# Autodesk Inventor assembly: Final QArm Gripper
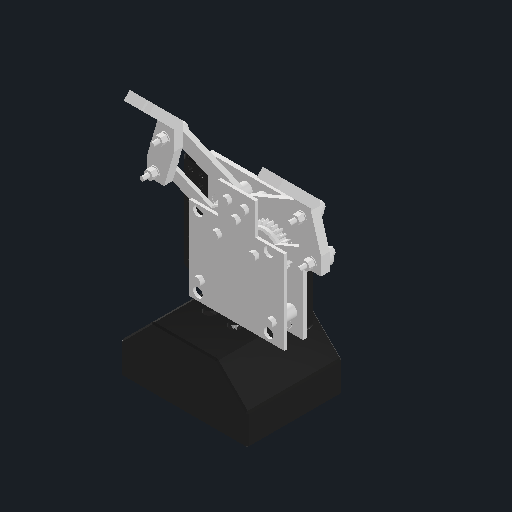
[picture p0: Inventor's stored thumbnail of the model, 512x512]
Saved by Autodesk Inventor 2027.1 (Build 311270010, 270A)
## iProperties
Created: 2026-11-03
Part Number: Final QArm Gripper
Document SubType Name: Assembly
Designer: anshi
Author: anshi
## Documents named in this file (25)
- C:\Users\anshi\Desktop\school\1P13\Design Studio\proj1 cad1\finalparts\Final QArm Gripper.iam
- C:\Users\anshi\Desktop\school\1P13\Design Studio\proj1 cad1\finalparts\P1-01_Lower_Mounting_Frame.ipt
- C:\Users\anshi\Desktop\school\1P13\Design Studio\proj1 cad1\finalparts\P4-04 Upper axle-support plate.ipt
- C:\Users\anshi\Desktop\school\1P13\Design Studio\proj1 cad1\finalparts\P1-02 Design Study Structural Pillar.ipt
- P1-02 Design Studio Structural Pillar.ipt
- C:\Users\anshi\Desktop\school\1P13\Design Studio\proj1 cad1\finalparts\UpperPivotSpacer.ipt
- C:\Users\anshi\Desktop\school\1P13\Design Studio\proj1 cad1\finalparts\Hardware\M3x20 socket screw.ipt
- C:\Users\anshi\Desktop\school\1P13\Design Studio\proj1 cad1\finalparts\Hardware\M3 hex nut.ipt
- C:\Users\anshi\Desktop\school\1P13\Design Studio\proj1 cad1\finalparts\P2-01 Input pinion 18 teeth.ipt
- C:\Users\anshi\Desktop\school\1P13\Design Studio\proj1 cad1\finalparts\Update 1.2 Uppercrankline and Left Driven Gears.ipt
- C:\Users\anshi\Desktop\school\1P13\Design Studio\proj1 cad1\finalparts\LowerFollowerLink.ipt
- C:\Users\anshi\Desktop\school\1P13\Design Studio\proj1 cad1\finalparts\LowerPivotSpacer.ipt
- C:\Users\anshi\Desktop\school\1P13\Design Studio\proj1 cad1\finalparts\Update 1.2 Left Finger and Pad Carrier.ipt
- C:\Users\anshi\Desktop\school\1P13\Design Studio\proj1 cad1\finalparts\P4-05 Foam contact pad.ipt
- C:\Users\anshi\Desktop\school\1P13\Design Studio\proj1 cad1\finalparts\Hardware\M3 washer 0.5mm.ipt
- C:\Users\anshi\Desktop\school\1P13\Design Studio\proj1 cad1\finalparts\Hardware\M3 nyloc nut.ipt
- C:\Users\anshi\Desktop\school\1P13\Design Studio\proj1 cad1\finalparts\Update 1.2 Uppercrankline and Right Driven Gears.ipt
- C:\Users\anshi\Desktop\school\1P13\Design Studio\proj1 cad1\finalparts\Update 1.2 Right Finger and Pad Carrier.ipt
- C:\Users\anshi\Desktop\school\1P13\Design Studio\proj1 cad1\finalparts\ReferencePlatform\End Effector Platform - rotating shaft reference.iam
- C:\Users\anshi\Desktop\school\1P13\Design Studio\proj1 cad1\finalparts\Hardware\M3x10 countersunk screw.ipt
- C:\Users\anshi\Desktop\school\1P13\Design Studio\proj1 cad1\finalparts\Hardware\N20 rotating output shaft reference.ipt
- C:\Users\anshi\Desktop\school\1P13\Design Studio\proj1 cad1\finalparts\Hardware\M3x4 grub screw.ipt
- C:\Users\anshi\Desktop\school\1P13\Design Studio\proj1 cad1\finalparts\Hardware\Pivot sleeve 4OD 3.2ID x10.5.ipt
- C:\Users\anshi\Desktop\school\1P13\Design Studio\proj1 cad1\finalparts\Hardware\Pivot sleeve 4OD 3.2ID x11.ipt
- C:\Users\anshi\Desktop\school\1P13\Design Studio\proj1 cad1\finalparts\Hardware\M3x16 socket screw.ipt
## Components (73 placed, 73 different names)
1. Lower mounting frame — Upper axle-support plate - datum 1, Upper axle-support plate - datum 2, Upper axle-support plate - datum 3, Structural pillar 1 - datum 1, Structural pillar 1 - datum 2, Structural pillar 1 - datum 3, Structural pillar 2 - datum 1, Structural pillar 2 - datum 2, Structural pillar 2 - datum 3, Structural pillar 3 - datum 1, Structural pillar 3 - datum 2, Structural pillar 3 - datum 3, Upper pivot spacer 1 - datum 1, Upper pivot spacer 1 - datum 2, Upper pivot spacer 1 - datum 3, Fixed pivot metal sleeve 1 - datum 1, Fixed pivot metal sleeve 1 - datum 2, Fixed pivot metal sleeve 1 - datum 3, Upper pivot spacer 2 - datum 1, Upper pivot spacer 2 - datum 2, Upper pivot spacer 2 - datum 3, Fixed pivot metal sleeve 2 - datum 1, Fixed pivot metal sleeve 2 - datum 2, Fixed pivot metal sleeve 2 - datum 3, Upper pivot spacer 3 - datum 1, Upper pivot spacer 3 - datum 2, Upper pivot spacer 3 - datum 3, Fixed pivot metal sleeve 3 - datum 1, Fixed pivot metal sleeve 3 - datum 2, Fixed pivot metal sleeve 3 - datum 3, Upper pivot spacer 4 - datum 1, Upper pivot spacer 4 - datum 2, Upper pivot spacer 4 - datum 3, Fixed pivot metal sleeve 4 - datum 1, Fixed pivot metal sleeve 4 - datum 2, Fixed pivot metal sleeve 4 - datum 3, M3 frame bolt 1 - datum 1, M3 frame bolt 1 - datum 2, M3 frame bolt 1 - datum 3, M3 frame bolt 2 - datum 1, M3 frame bolt 2 - datum 2, M3 frame bolt 2 - datum 3, M3 frame bolt 3 - datum 1, M3 frame bolt 3 - datum 2, M3 frame bolt 3 - datum 3, M3 frame bolt 4 - datum 1, M3 frame bolt 4 - datum 2, M3 frame bolt 4 - datum 3, M3 captive frame nut 4 - datum 1, M3 captive frame nut 4 - datum 2, M3 captive frame nut 4 - datum 3, M3 frame bolt 5 - datum 1, M3 frame bolt 5 - datum 2, M3 frame bolt 5 - datum 3, M3 captive frame nut 5 - datum 1, M3 captive frame nut 5 - datum 2, M3 captive frame nut 5 - datum 3, M3 frame bolt 6 - datum 1, M3 frame bolt 6 - datum 2, M3 frame bolt 6 - datum 3, M3 captive frame nut 6 - datum 1, M3 captive frame nut 6 - datum 2, M3 captive frame nut 6 - datum 3, M3 frame bolt 7 - datum 1, M3 frame bolt 7 - datum 2, M3 frame bolt 7 - datum 3, M3 captive frame nut 7 - datum 1, M3 captive frame nut 7 - datum 2, M3 captive frame nut 7 - datum 3, Left lower pivot spacer - datum 1, Left lower pivot spacer - datum 2, Left lower pivot spacer - datum 3, Right lower pivot spacer - datum 1, Right lower pivot spacer - datum 2, Right lower pivot spacer - datum 3, QArm supplied end effector platform - datum 1, QArm supplied end effector platform - datum 2, QArm supplied end effector platform - datum 3, Platform M3 mounting screw 1 - datum 1, Platform M3 mounting screw 1 - datum 2, Platform M3 mounting screw 1 - datum 3, Platform M3 washer 1 - datum 1, Platform M3 washer 1 - datum 2, Platform M3 washer 1 - datum 3, Platform M3 nut 1 - datum 1, Platform M3 nut 1 - datum 2, Platform M3 nut 1 - datum 3, Platform M3 mounting screw 2 - datum 1, Platform M3 mounting screw 2 - datum 2, Platform M3 mounting screw 2 - datum 3, Platform M3 washer 2 - datum 1, Platform M3 washer 2 - datum 2, Platform M3 washer 2 - datum 3, Platform M3 nut 2 - datum 1, Platform M3 nut 2 - datum 2, Platform M3 nut 2 - datum 3, Platform M3 mounting screw 3 - datum 1, Platform M3 mounting screw 3 - datum 2, Platform M3 mounting screw 3 - datum 3, Platform M3 washer 3 - datum 1, Platform M3 washer 3 - datum 2, Platform M3 washer 3 - datum 3, Platform M3 nut 3 - datum 1, Platform M3 nut 3 - datum 2, Platform M3 nut 3 - datum 3, Platform M3 mounting screw 4 - datum 1, Platform M3 mounting screw 4 - datum 2, Platform M3 mounting screw 4 - datum 3, Platform M3 washer 4 - datum 1, Platform M3 washer 4 - datum 2, Platform M3 washer 4 - datum 3, Platform M3 nut 4 - datum 1, Platform M3 nut 4 - datum 2, Platform M3 nut 4 - datum 3, Input pinion height, Input shaft axis, Left gear face height, Left gear pivot, Left follower height, Left follower pivot, Left finger height, Right gear face height, Right gear pivot, Right follower height, Right follower pivot, Right finger height, Jaw opening drive, M3 captive frame nut 1 axis, M3 captive frame nut 1 height, M3 captive frame nut 1 pocket orientation, M3 captive frame nut 2 axis, M3 captive frame nut 2 height, M3 captive frame nut 2 pocket orientation, M3 captive frame nut 3 axis, M3 captive frame nut 3 height, M3 captive frame nut 3 pocket orientation
2. Upper axle-support plate — Upper axle-support plate - datum 1, Upper axle-support plate - datum 2, Upper axle-support plate - datum 3
3. Structural pillar 1 — Structural pillar 1 - datum 1, Structural pillar 1 - datum 2, Structural pillar 1 - datum 3
4. Structural pillar 2 — Structural pillar 2 - datum 1, Structural pillar 2 - datum 2, Structural pillar 2 - datum 3
5. Structural pillar 3 — Structural pillar 3 - datum 1, Structural pillar 3 - datum 2, Structural pillar 3 - datum 3
6. Upper pivot spacer 1 — Upper pivot spacer 1 - datum 1, Upper pivot spacer 1 - datum 2, Upper pivot spacer 1 - datum 3
7. Fixed pivot metal sleeve 1 — Fixed pivot metal sleeve 1 - datum 1, Fixed pivot metal sleeve 1 - datum 2, Fixed pivot metal sleeve 1 - datum 3
8. Upper pivot spacer 2 — Upper pivot spacer 2 - datum 1, Upper pivot spacer 2 - datum 2, Upper pivot spacer 2 - datum 3
9. Fixed pivot metal sleeve 2 — Fixed pivot metal sleeve 2 - datum 1, Fixed pivot metal sleeve 2 - datum 2, Fixed pivot metal sleeve 2 - datum 3
10. Upper pivot spacer 3 — Upper pivot spacer 3 - datum 1, Upper pivot spacer 3 - datum 2, Upper pivot spacer 3 - datum 3
11. Fixed pivot metal sleeve 3 — Fixed pivot metal sleeve 3 - datum 1, Fixed pivot metal sleeve 3 - datum 2, Fixed pivot metal sleeve 3 - datum 3
12. Upper pivot spacer 4 — Upper pivot spacer 4 - datum 1, Upper pivot spacer 4 - datum 2, Upper pivot spacer 4 - datum 3
13. Fixed pivot metal sleeve 4 — Fixed pivot metal sleeve 4 - datum 1, Fixed pivot metal sleeve 4 - datum 2, Fixed pivot metal sleeve 4 - datum 3
14. M3 frame bolt 1 — M3 frame bolt 1 - datum 1, M3 frame bolt 1 - datum 2, M3 frame bolt 1 - datum 3
15. M3 captive frame nut 1 — M3 captive frame nut 1 axis, M3 captive frame nut 1 height, M3 captive frame nut 1 pocket orientation
16. M3 frame bolt 2 — M3 frame bolt 2 - datum 1, M3 frame bolt 2 - datum 2, M3 frame bolt 2 - datum 3
17. M3 captive frame nut 2 — M3 captive frame nut 2 axis, M3 captive frame nut 2 height, M3 captive frame nut 2 pocket orientation
18. M3 frame bolt 3 — M3 frame bolt 3 - datum 1, M3 frame bolt 3 - datum 2, M3 frame bolt 3 - datum 3
19. M3 captive frame nut 3 — M3 captive frame nut 3 axis, M3 captive frame nut 3 height, M3 captive frame nut 3 pocket orientation
20. M3 frame bolt 4 — M3 frame bolt 4 - datum 1, M3 frame bolt 4 - datum 2, M3 frame bolt 4 - datum 3
21. M3 captive frame nut 4 — M3 captive frame nut 4 - datum 1, M3 captive frame nut 4 - datum 2, M3 captive frame nut 4 - datum 3
22. M3 frame bolt 5 — M3 frame bolt 5 - datum 1, M3 frame bolt 5 - datum 2, M3 frame bolt 5 - datum 3
23. M3 captive frame nut 5 — M3 captive frame nut 5 - datum 1, M3 captive frame nut 5 - datum 2, M3 captive frame nut 5 - datum 3
24. M3 frame bolt 6 — M3 frame bolt 6 - datum 1, M3 frame bolt 6 - datum 2, M3 frame bolt 6 - datum 3
25. M3 captive frame nut 6 — M3 captive frame nut 6 - datum 1, M3 captive frame nut 6 - datum 2, M3 captive frame nut 6 - datum 3
26. M3 frame bolt 7 — M3 frame bolt 7 - datum 1, M3 frame bolt 7 - datum 2, M3 frame bolt 7 - datum 3
27. M3 captive frame nut 7 — M3 captive frame nut 7 - datum 1, M3 captive frame nut 7 - datum 2, M3 captive frame nut 7 - datum 3
28. Motor input pinion 18T — Input pinion height, Input shaft axis, 26T to 18T external gear mesh, Rotating motor output shaft - datum 1, Rotating motor output shaft - datum 2, Rotating motor output shaft - datum 3, M3 motor shaft set screw - datum 1, M3 motor shaft set screw - datum 2, M3 motor shaft set screw - datum 3
29. Left driven gear 26T — Left gear face height, Left gear pivot, Left finger upper pivot, 26T to 26T external gear mesh, 26T to 18T external gear mesh, Jaw opening drive
30. Left lower follower — Left follower height, Left follower pivot, Left finger lower pivot
31. Left lower pivot spacer — Left lower pivot spacer - datum 1, Left lower pivot spacer - datum 2, Left lower pivot spacer - datum 3
32. Left finger — Left finger height, Left finger upper pivot, Left finger lower pivot, Left finger pivot 1 metal sleeve - datum 1, Left finger pivot 1 metal sleeve - datum 2, Left finger pivot 1 metal sleeve - datum 3, Left finger pivot 1 M3 bolt - datum 1, Left finger pivot 1 M3 bolt - datum 2, Left finger pivot 1 M3 bolt - datum 3, Left finger pivot 1 lower washer - datum 1, Left finger pivot 1 lower washer - datum 2, Left finger pivot 1 lower washer - datum 3, Left finger pivot 1 upper washer - datum 1, Left finger pivot 1 upper washer - datum 2, Left finger pivot 1 upper washer - datum 3, Left finger pivot 1 M3 locking nut - datum 1, Left finger pivot 1 M3 locking nut - datum 2, Left finger pivot 1 M3 locking nut - datum 3, Left finger pivot 2 metal sleeve - datum 1, Left finger pivot 2 metal sleeve - datum 2, Left finger pivot 2 metal sleeve - datum 3, Left finger pivot 2 M3 bolt - datum 1, Left finger pivot 2 M3 bolt - datum 2, Left finger pivot 2 M3 bolt - datum 3, Left finger pivot 2 lower washer - datum 1, Left finger pivot 2 lower washer - datum 2, Left finger pivot 2 lower washer - datum 3, Left finger pivot 2 upper washer - datum 1, Left finger pivot 2 upper washer - datum 2, Left finger pivot 2 upper washer - datum 3, Left finger pivot 2 M3 locking nut - datum 1, Left finger pivot 2 M3 locking nut - datum 2, Left finger pivot 2 M3 locking nut - datum 3, Left foam contact pad - datum 1, Left foam contact pad - datum 2, Left foam contact pad - datum 3
33. Left foam contact pad — Left foam contact pad - datum 1, Left foam contact pad - datum 2, Left foam contact pad - datum 3
34. Left finger pivot 1 metal sleeve — Left finger pivot 1 metal sleeve - datum 1, Left finger pivot 1 metal sleeve - datum 2, Left finger pivot 1 metal sleeve - datum 3
35. Left finger pivot 1 M3 bolt — Left finger pivot 1 M3 bolt - datum 1, Left finger pivot 1 M3 bolt - datum 2, Left finger pivot 1 M3 bolt - datum 3
36. Left finger pivot 1 lower washer — Left finger pivot 1 lower washer - datum 1, Left finger pivot 1 lower washer - datum 2, Left finger pivot 1 lower washer - datum 3
37. Left finger pivot 1 upper washer — Left finger pivot 1 upper washer - datum 1, Left finger pivot 1 upper washer - datum 2, Left finger pivot 1 upper washer - datum 3
38. Left finger pivot 1 M3 locking nut — Left finger pivot 1 M3 locking nut - datum 1, Left finger pivot 1 M3 locking nut - datum 2, Left finger pivot 1 M3 locking nut - datum 3
39. Left finger pivot 2 metal sleeve — Left finger pivot 2 metal sleeve - datum 1, Left finger pivot 2 metal sleeve - datum 2, Left finger pivot 2 metal sleeve - datum 3
40. Left finger pivot 2 M3 bolt — Left finger pivot 2 M3 bolt - datum 1, Left finger pivot 2 M3 bolt - datum 2, Left finger pivot 2 M3 bolt - datum 3
41. Left finger pivot 2 lower washer — Left finger pivot 2 lower washer - datum 1, Left finger pivot 2 lower washer - datum 2, Left finger pivot 2 lower washer - datum 3
42. Left finger pivot 2 upper washer — Left finger pivot 2 upper washer - datum 1, Left finger pivot 2 upper washer - datum 2, Left finger pivot 2 upper washer - datum 3
43. Left finger pivot 2 M3 locking nut — Left finger pivot 2 M3 locking nut - datum 1, Left finger pivot 2 M3 locking nut - datum 2, Left finger pivot 2 M3 locking nut - datum 3
44. Right driven gear 26T — Right gear face height, Right gear pivot, Right finger upper pivot, 26T to 26T external gear mesh
45. Right lower follower — Right follower height, Right follower pivot, Right finger lower pivot
46. Right lower pivot spacer — Right lower pivot spacer - datum 1, Right lower pivot spacer - datum 2, Right lower pivot spacer - datum 3
47. Right finger — Right finger height, Right finger upper pivot, Right finger lower pivot, Right finger pivot 1 metal sleeve - datum 1, Right finger pivot 1 metal sleeve - datum 2, Right finger pivot 1 metal sleeve - datum 3, Right finger pivot 1 M3 bolt - datum 1, Right finger pivot 1 M3 bolt - datum 2, Right finger pivot 1 M3 bolt - datum 3, Right finger pivot 1 lower washer - datum 1, Right finger pivot 1 lower washer - datum 2, Right finger pivot 1 lower washer - datum 3, Right finger pivot 1 upper washer - datum 1, Right finger pivot 1 upper washer - datum 2, Right finger pivot 1 upper washer - datum 3, Right finger pivot 1 M3 locking nut - datum 1, Right finger pivot 1 M3 locking nut - datum 2, Right finger pivot 1 M3 locking nut - datum 3, Right finger pivot 2 metal sleeve - datum 1, Right finger pivot 2 metal sleeve - datum 2, Right finger pivot 2 metal sleeve - datum 3, Right finger pivot 2 M3 bolt - datum 1, Right finger pivot 2 M3 bolt - datum 2, Right finger pivot 2 M3 bolt - datum 3, Right finger pivot 2 lower washer - datum 1, Right finger pivot 2 lower washer - datum 2, Right finger pivot 2 lower washer - datum 3, Right finger pivot 2 upper washer - datum 1, Right finger pivot 2 upper washer - datum 2, Right finger pivot 2 upper washer - datum 3, Right finger pivot 2 M3 locking nut - datum 1, Right finger pivot 2 M3 locking nut - datum 2, Right finger pivot 2 M3 locking nut - datum 3, Right foam contact pad - datum 1, Right foam contact pad - datum 2, Right foam contact pad - datum 3
48. Right foam contact pad — Right foam contact pad - datum 1, Right foam contact pad - datum 2, Right foam contact pad - datum 3
49. Right finger pivot 1 metal sleeve — Right finger pivot 1 metal sleeve - datum 1, Right finger pivot 1 metal sleeve - datum 2, Right finger pivot 1 metal sleeve - datum 3
50. Right finger pivot 1 M3 bolt — Right finger pivot 1 M3 bolt - datum 1, Right finger pivot 1 M3 bolt - datum 2, Right finger pivot 1 M3 bolt - datum 3
51. Right finger pivot 1 lower washer — Right finger pivot 1 lower washer - datum 1, Right finger pivot 1 lower washer - datum 2, Right finger pivot 1 lower washer - datum 3
52. Right finger pivot 1 upper washer — Right finger pivot 1 upper washer - datum 1, Right finger pivot 1 upper washer - datum 2, Right finger pivot 1 upper washer - datum 3
53. Right finger pivot 1 M3 locking nut — Right finger pivot 1 M3 locking nut - datum 1, Right finger pivot 1 M3 locking nut - datum 2, Right finger pivot 1 M3 locking nut - datum 3
54. Right finger pivot 2 metal sleeve — Right finger pivot 2 metal sleeve - datum 1, Right finger pivot 2 metal sleeve - datum 2, Right finger pivot 2 metal sleeve - datum 3
55. Right finger pivot 2 M3 bolt — Right finger pivot 2 M3 bolt - datum 1, Right finger pivot 2 M3 bolt - datum 2, Right finger pivot 2 M3 bolt - datum 3
56. Right finger pivot 2 lower washer — Right finger pivot 2 lower washer - datum 1, Right finger pivot 2 lower washer - datum 2, Right finger pivot 2 lower washer - datum 3
57. Right finger pivot 2 upper washer — Right finger pivot 2 upper washer - datum 1, Right finger pivot 2 upper washer - datum 2, Right finger pivot 2 upper washer - datum 3
58. Right finger pivot 2 M3 locking nut — Right finger pivot 2 M3 locking nut - datum 1, Right finger pivot 2 M3 locking nut - datum 2, Right finger pivot 2 M3 locking nut - datum 3
59. QArm supplied end effector platform [sub-assembly] — QArm supplied end effector platform - datum 1, QArm supplied end effector platform - datum 2, QArm supplied end effector platform - datum 3
60. Platform M3 mounting screw 1 — Platform M3 mounting screw 1 - datum 1, Platform M3 mounting screw 1 - datum 2, Platform M3 mounting screw 1 - datum 3
61. Platform M3 washer 1 — Platform M3 washer 1 - datum 1, Platform M3 washer 1 - datum 2, Platform M3 washer 1 - datum 3
62. Platform M3 nut 1 — Platform M3 nut 1 - datum 1, Platform M3 nut 1 - datum 2, Platform M3 nut 1 - datum 3
63. Platform M3 mounting screw 2 — Platform M3 mounting screw 2 - datum 1, Platform M3 mounting screw 2 - datum 2, Platform M3 mounting screw 2 - datum 3
64. Platform M3 washer 2 — Platform M3 washer 2 - datum 1, Platform M3 washer 2 - datum 2, Platform M3 washer 2 - datum 3
65. Platform M3 nut 2 — Platform M3 nut 2 - datum 1, Platform M3 nut 2 - datum 2, Platform M3 nut 2 - datum 3
66. Platform M3 mounting screw 3 — Platform M3 mounting screw 3 - datum 1, Platform M3 mounting screw 3 - datum 2, Platform M3 mounting screw 3 - datum 3
67. Platform M3 washer 3 — Platform M3 washer 3 - datum 1, Platform M3 washer 3 - datum 2, Platform M3 washer 3 - datum 3
68. Platform M3 nut 3 — Platform M3 nut 3 - datum 1, Platform M3 nut 3 - datum 2, Platform M3 nut 3 - datum 3
69. Platform M3 mounting screw 4 — Platform M3 mounting screw 4 - datum 1, Platform M3 mounting screw 4 - datum 2, Platform M3 mounting screw 4 - datum 3
70. Platform M3 washer 4 — Platform M3 washer 4 - datum 1, Platform M3 washer 4 - datum 2, Platform M3 washer 4 - datum 3
71. Platform M3 nut 4 — Platform M3 nut 4 - datum 1, Platform M3 nut 4 - datum 2, Platform M3 nut 4 - datum 3
72. Rotating motor output shaft — Rotating motor output shaft - datum 1, Rotating motor output shaft - datum 2, Rotating motor output shaft - datum 3
73. M3 motor shaft set screw — M3 motor shaft set screw - datum 1, M3 motor shaft set screw - datum 2, M3 motor shaft set screw - datum 3
## Relationships (214: Flush 171, Mate 37, Angle 4, RelateRotation 2)
- Upper axle-support plate - datum 1 [Flush]: Lower mounting frame ↔ Upper axle-support plate
- Upper axle-support plate - datum 2 [Flush]: Lower mounting frame ↔ Upper axle-support plate
- Upper axle-support plate - datum 3 [Flush] (14 mm): Lower mounting frame ↔ Upper axle-support plate
- Structural pillar 1 - datum 1 [Flush] (-12 mm): Lower mounting frame ↔ Structural pillar 1
- Structural pillar 1 - datum 2 [Flush] (3 mm): Lower mounting frame ↔ Structural pillar 1
- Structural pillar 1 - datum 3 [Mate] (-12 mm): Lower mounting frame ↔ Structural pillar 1
- Structural pillar 2 - datum 1 [Flush] (38 mm): Lower mounting frame ↔ Structural pillar 2
- Structural pillar 2 - datum 2 [Flush] (3 mm): Lower mounting frame ↔ Structural pillar 2
- Structural pillar 2 - datum 3 [Mate] (-12 mm): Lower mounting frame ↔ Structural pillar 2
- Structural pillar 3 - datum 1 [Flush] (13 mm): Lower mounting frame ↔ Structural pillar 3
- Structural pillar 3 - datum 2 [Flush] (3 mm): Lower mounting frame ↔ Structural pillar 3
- Structural pillar 3 - datum 3 [Mate] (37 mm): Lower mounting frame ↔ Structural pillar 3
- Upper pivot spacer 1 - datum 1 [Flush]: Lower mounting frame ↔ Upper pivot spacer 1
- Upper pivot spacer 1 - datum 2 [Flush] (11.5 mm): Lower mounting frame ↔ Upper pivot spacer 1
- Upper pivot spacer 1 - datum 3 [Mate] (22 mm): Lower mounting frame ↔ Upper pivot spacer 1
- Fixed pivot metal sleeve 1 - datum 1 [Flush]: Lower mounting frame ↔ Fixed pivot metal sleeve 1
- Fixed pivot metal sleeve 1 - datum 2 [Flush] (22 mm): Lower mounting frame ↔ Fixed pivot metal sleeve 1
- Fixed pivot metal sleeve 1 - datum 3 [Flush] (3 mm): Lower mounting frame ↔ Fixed pivot metal sleeve 1
- Upper pivot spacer 2 - datum 1 [Flush] (26 mm): Lower mounting frame ↔ Upper pivot spacer 2
- Upper pivot spacer 2 - datum 2 [Flush] (11.5 mm): Lower mounting frame ↔ Upper pivot spacer 2
- Upper pivot spacer 2 - datum 3 [Mate] (22 mm): Lower mounting frame ↔ Upper pivot spacer 2
- Fixed pivot metal sleeve 2 - datum 1 [Flush] (26 mm): Lower mounting frame ↔ Fixed pivot metal sleeve 2
- Fixed pivot metal sleeve 2 - datum 2 [Flush] (22 mm): Lower mounting frame ↔ Fixed pivot metal sleeve 2
- Fixed pivot metal sleeve 2 - datum 3 [Flush] (3 mm): Lower mounting frame ↔ Fixed pivot metal sleeve 2
- Upper pivot spacer 3 - datum 1 [Flush] (7 mm): Lower mounting frame ↔ Upper pivot spacer 3
- Upper pivot spacer 3 - datum 2 [Flush] (11.5 mm): Lower mounting frame ↔ Upper pivot spacer 3
- Upper pivot spacer 3 - datum 3 [Mate] (46 mm): Lower mounting frame ↔ Upper pivot spacer 3
- Fixed pivot metal sleeve 3 - datum 1 [Flush] (7 mm): Lower mounting frame ↔ Fixed pivot metal sleeve 3
- Fixed pivot metal sleeve 3 - datum 2 [Flush] (46 mm): Lower mounting frame ↔ Fixed pivot metal sleeve 3
- Fixed pivot metal sleeve 3 - datum 3 [Flush] (3 mm): Lower mounting frame ↔ Fixed pivot metal sleeve 3
- Upper pivot spacer 4 - datum 1 [Flush] (19 mm): Lower mounting frame ↔ Upper pivot spacer 4
- Upper pivot spacer 4 - datum 2 [Flush] (11.5 mm): Lower mounting frame ↔ Upper pivot spacer 4
- Upper pivot spacer 4 - datum 3 [Mate] (46 mm): Lower mounting frame ↔ Upper pivot spacer 4
- Fixed pivot metal sleeve 4 - datum 1 [Flush] (19 mm): Lower mounting frame ↔ Fixed pivot metal sleeve 4
- Fixed pivot metal sleeve 4 - datum 2 [Flush] (46 mm): Lower mounting frame ↔ Fixed pivot metal sleeve 4
- Fixed pivot metal sleeve 4 - datum 3 [Flush] (3 mm): Lower mounting frame ↔ Fixed pivot metal sleeve 4
- M3 frame bolt 1 - datum 1 [Flush] (-12 mm): Lower mounting frame ↔ M3 frame bolt 1
- M3 frame bolt 1 - datum 2 [Mate] (-12 mm): Lower mounting frame ↔ M3 frame bolt 1
- M3 frame bolt 1 - datum 3 [Mate] (16 mm): Lower mounting frame ↔ M3 frame bolt 1
- M3 frame bolt 2 - datum 1 [Flush] (38 mm): Lower mounting frame ↔ M3 frame bolt 2
- M3 frame bolt 2 - datum 2 [Mate] (-12 mm): Lower mounting frame ↔ M3 frame bolt 2
- M3 frame bolt 2 - datum 3 [Mate] (16 mm): Lower mounting frame ↔ M3 frame bolt 2
- M3 frame bolt 3 - datum 1 [Flush] (13 mm): Lower mounting frame ↔ M3 frame bolt 3
- M3 frame bolt 3 - datum 2 [Mate] (37 mm): Lower mounting frame ↔ M3 frame bolt 3
- M3 frame bolt 3 - datum 3 [Mate] (16 mm): Lower mounting frame ↔ M3 frame bolt 3
- M3 frame bolt 4 - datum 1 [Flush]: Lower mounting frame ↔ M3 frame bolt 4
- M3 frame bolt 4 - datum 2 [Mate] (22 mm): Lower mounting frame ↔ M3 frame bolt 4
- M3 frame bolt 4 - datum 3 [Mate] (16 mm): Lower mounting frame ↔ M3 frame bolt 4
- M3 captive frame nut 4 - datum 1 [Flush]: Lower mounting frame ↔ M3 captive frame nut 4
- M3 captive frame nut 4 - datum 2 [Flush] (22 mm): Lower mounting frame ↔ M3 captive frame nut 4
- M3 captive frame nut 4 - datum 3 [Flush]: Lower mounting frame ↔ M3 captive frame nut 4
- M3 frame bolt 5 - datum 1 [Flush] (26 mm): Lower mounting frame ↔ M3 frame bolt 5
- M3 frame bolt 5 - datum 2 [Mate] (22 mm): Lower mounting frame ↔ M3 frame bolt 5
- M3 frame bolt 5 - datum 3 [Mate] (16 mm): Lower mounting frame ↔ M3 frame bolt 5
- M3 captive frame nut 5 - datum 1 [Flush] (26 mm): Lower mounting frame ↔ M3 captive frame nut 5
- M3 captive frame nut 5 - datum 2 [Flush] (22 mm): Lower mounting frame ↔ M3 captive frame nut 5
- M3 captive frame nut 5 - datum 3 [Flush]: Lower mounting frame ↔ M3 captive frame nut 5
- M3 frame bolt 6 - datum 1 [Flush] (7 mm): Lower mounting frame ↔ M3 frame bolt 6
- M3 frame bolt 6 - datum 2 [Mate] (46 mm): Lower mounting frame ↔ M3 frame bolt 6
- M3 frame bolt 6 - datum 3 [Mate] (16 mm): Lower mounting frame ↔ M3 frame bolt 6
- M3 captive frame nut 6 - datum 1 [Flush] (7 mm): Lower mounting frame ↔ M3 captive frame nut 6
- M3 captive frame nut 6 - datum 2 [Flush] (46 mm): Lower mounting frame ↔ M3 captive frame nut 6
- M3 captive frame nut 6 - datum 3 [Flush]: Lower mounting frame ↔ M3 captive frame nut 6
- M3 frame bolt 7 - datum 1 [Flush] (19 mm): Lower mounting frame ↔ M3 frame bolt 7
- M3 frame bolt 7 - datum 2 [Mate] (46 mm): Lower mounting frame ↔ M3 frame bolt 7
- M3 frame bolt 7 - datum 3 [Mate] (16 mm): Lower mounting frame ↔ M3 frame bolt 7
- M3 captive frame nut 7 - datum 1 [Flush] (19 mm): Lower mounting frame ↔ M3 captive frame nut 7
- M3 captive frame nut 7 - datum 2 [Flush] (46 mm): Lower mounting frame ↔ M3 captive frame nut 7
- M3 captive frame nut 7 - datum 3 [Flush]: Lower mounting frame ↔ M3 captive frame nut 7
- Left lower pivot spacer - datum 1 [Flush] (7 mm): Lower mounting frame ↔ Left lower pivot spacer
- Left lower pivot spacer - datum 2 [Flush] (3 mm): Lower mounting frame ↔ Left lower pivot spacer
- Left lower pivot spacer - datum 3 [Mate] (46 mm): Lower mounting frame ↔ Left lower pivot spacer
- Right lower pivot spacer - datum 1 [Flush] (19 mm): Lower mounting frame ↔ Right lower pivot spacer
- Right lower pivot spacer - datum 2 [Flush] (3 mm): Lower mounting frame ↔ Right lower pivot spacer
- Right lower pivot spacer - datum 3 [Mate] (46 mm): Lower mounting frame ↔ Right lower pivot spacer
- QArm supplied end effector platform - datum 1 [Mate] (-1.9665 mm): Lower mounting frame ↔ QArm supplied end effector platform
- QArm supplied end effector platform - datum 2 [Mate] (-40.0306 mm): Lower mounting frame ↔ QArm supplied end effector platform
- QArm supplied end effector platform - datum 3 [Flush] (5.6946 mm): Lower mounting frame ↔ QArm supplied end effector platform
- Platform M3 mounting screw 1 - datum 1 [Flush] (-14 mm): Lower mounting frame ↔ Platform M3 mounting screw 1
- Platform M3 mounting screw 1 - datum 2 [Flush] (-21 mm): Lower mounting frame ↔ Platform M3 mounting screw 1
- Platform M3 mounting screw 1 - datum 3 [Flush] (-7 mm): Lower mounting frame ↔ Platform M3 mounting screw 1
- Platform M3 washer 1 - datum 1 [Flush] (-14 mm): Lower mounting frame ↔ Platform M3 washer 1
- Platform M3 washer 1 - datum 2 [Flush] (-21 mm): Lower mounting frame ↔ Platform M3 washer 1
- Platform M3 washer 1 - datum 3 [Flush] (-3 mm): Lower mounting frame ↔ Platform M3 washer 1
- Platform M3 nut 1 - datum 1 [Flush] (-14 mm): Lower mounting frame ↔ Platform M3 nut 1
- Platform M3 nut 1 - datum 2 [Flush] (-21 mm): Lower mounting frame ↔ Platform M3 nut 1
- Platform M3 nut 1 - datum 3 [Flush] (-5.4 mm): Lower mounting frame ↔ Platform M3 nut 1
- Platform M3 mounting screw 2 - datum 1 [Flush] (35 mm): Lower mounting frame ↔ Platform M3 mounting screw 2
- Platform M3 mounting screw 2 - datum 2 [Flush] (-21 mm): Lower mounting frame ↔ Platform M3 mounting screw 2
- Platform M3 mounting screw 2 - datum 3 [Flush] (-7 mm): Lower mounting frame ↔ Platform M3 mounting screw 2
- Platform M3 washer 2 - datum 1 [Flush] (35 mm): Lower mounting frame ↔ Platform M3 washer 2
- Platform M3 washer 2 - datum 2 [Flush] (-21 mm): Lower mounting frame ↔ Platform M3 washer 2
- Platform M3 washer 2 - datum 3 [Flush] (-3 mm): Lower mounting frame ↔ Platform M3 washer 2
- Platform M3 nut 2 - datum 1 [Flush] (35 mm): Lower mounting frame ↔ Platform M3 nut 2
- Platform M3 nut 2 - datum 2 [Flush] (-21 mm): Lower mounting frame ↔ Platform M3 nut 2
- Platform M3 nut 2 - datum 3 [Flush] (-5.4 mm): Lower mounting frame ↔ Platform M3 nut 2
- Platform M3 mounting screw 3 - datum 1 [Flush] (-14 mm): Lower mounting frame ↔ Platform M3 mounting screw 3
- Platform M3 mounting screw 3 - datum 2 [Flush] (28 mm): Lower mounting frame ↔ Platform M3 mounting screw 3
- Platform M3 mounting screw 3 - datum 3 [Flush] (-7 mm): Lower mounting frame ↔ Platform M3 mounting screw 3
- Platform M3 washer 3 - datum 1 [Flush] (-14 mm): Lower mounting frame ↔ Platform M3 washer 3
- Platform M3 washer 3 - datum 2 [Flush] (28 mm): Lower mounting frame ↔ Platform M3 washer 3
- Platform M3 washer 3 - datum 3 [Flush] (-3 mm): Lower mounting frame ↔ Platform M3 washer 3
- Platform M3 nut 3 - datum 1 [Flush] (-14 mm): Lower mounting frame ↔ Platform M3 nut 3
- Platform M3 nut 3 - datum 2 [Flush] (28 mm): Lower mounting frame ↔ Platform M3 nut 3
- Platform M3 nut 3 - datum 3 [Flush] (-5.4 mm): Lower mounting frame ↔ Platform M3 nut 3
- Platform M3 mounting screw 4 - datum 1 [Flush] (35 mm): Lower mounting frame ↔ Platform M3 mounting screw 4
- Platform M3 mounting screw 4 - datum 2 [Flush] (28 mm): Lower mounting frame ↔ Platform M3 mounting screw 4
- Platform M3 mounting screw 4 - datum 3 [Flush] (-7 mm): Lower mounting frame ↔ Platform M3 mounting screw 4
- Platform M3 washer 4 - datum 1 [Flush] (35 mm): Lower mounting frame ↔ Platform M3 washer 4
- Platform M3 washer 4 - datum 2 [Flush] (28 mm): Lower mounting frame ↔ Platform M3 washer 4
- Platform M3 washer 4 - datum 3 [Flush] (-3 mm): Lower mounting frame ↔ Platform M3 washer 4
- Platform M3 nut 4 - datum 1 [Flush] (35 mm): Lower mounting frame ↔ Platform M3 nut 4
- Platform M3 nut 4 - datum 2 [Flush] (28 mm): Lower mounting frame ↔ Platform M3 nut 4
- Platform M3 nut 4 - datum 3 [Flush] (-5.4 mm): Lower mounting frame ↔ Platform M3 nut 4
- Input pinion height [Flush] (0.5 mm): Lower mounting frame ↔ Motor input pinion 18T
- Input shaft axis [Mate]: Lower mounting frame ↔ Motor input pinion 18T
- Left gear face height [Flush] (3.5 mm): Lower mounting frame ↔ Left driven gear 26T
- Left gear pivot [Mate]: Lower mounting frame ↔ Left driven gear 26T
- Left follower height [Flush] (8 mm): Lower mounting frame ↔ Left lower follower
- Left follower pivot [Mate]: Lower mounting frame ↔ Left lower follower
- Left finger height [Flush] (12 mm): Lower mounting frame ↔ Left finger
- Left finger upper pivot [Mate]: Left driven gear 26T ↔ Left finger
- Left finger lower pivot [Mate]: Left lower follower ↔ Left finger
- Left finger pivot 1 metal sleeve - datum 1 [Flush]: Left finger ↔ Left finger pivot 1 metal sleeve
- Left finger pivot 1 metal sleeve - datum 2 [Flush]: Left finger ↔ Left finger pivot 1 metal sleeve
- Left finger pivot 1 metal sleeve - datum 3 [Flush] (-4 mm): Left finger ↔ Left finger pivot 1 metal sleeve
- Left finger pivot 1 M3 bolt - datum 1 [Flush]: Left finger ↔ Left finger pivot 1 M3 bolt
- Left finger pivot 1 M3 bolt - datum 2 [Flush]: Left finger ↔ Left finger pivot 1 M3 bolt
- Left finger pivot 1 M3 bolt - datum 3 [Flush] (-4.5 mm): Left finger ↔ Left finger pivot 1 M3 bolt
- Left finger pivot 1 lower washer - datum 1 [Flush]: Left finger ↔ Left finger pivot 1 lower washer
- Left finger pivot 1 lower washer - datum 2 [Flush]: Left finger ↔ Left finger pivot 1 lower washer
- Left finger pivot 1 lower washer - datum 3 [Flush] (-4.5 mm): Left finger ↔ Left finger pivot 1 lower washer
- Left finger pivot 1 upper washer - datum 1 [Flush]: Left finger ↔ Left finger pivot 1 upper washer
- Left finger pivot 1 upper washer - datum 2 [Flush]: Left finger ↔ Left finger pivot 1 upper washer
- Left finger pivot 1 upper washer - datum 3 [Flush] (6.5 mm): Left finger ↔ Left finger pivot 1 upper washer
- Left finger pivot 1 M3 locking nut - datum 1 [Flush]: Left finger ↔ Left finger pivot 1 M3 locking nut
- Left finger pivot 1 M3 locking nut - datum 2 [Flush]: Left finger ↔ Left finger pivot 1 M3 locking nut
- Left finger pivot 1 M3 locking nut - datum 3 [Flush] (7 mm): Left finger ↔ Left finger pivot 1 M3 locking nut
- Left finger pivot 2 metal sleeve - datum 1 [Flush] (7 mm): Left finger ↔ Left finger pivot 2 metal sleeve
- Left finger pivot 2 metal sleeve - datum 2 [Flush] (24 mm): Left finger ↔ Left finger pivot 2 metal sleeve
- Left finger pivot 2 metal sleeve - datum 3 [Flush] (-4 mm): Left finger ↔ Left finger pivot 2 metal sleeve
- Left finger pivot 2 M3 bolt - datum 1 [Flush] (7 mm): Left finger ↔ Left finger pivot 2 M3 bolt
- Left finger pivot 2 M3 bolt - datum 2 [Flush] (24 mm): Left finger ↔ Left finger pivot 2 M3 bolt
- Left finger pivot 2 M3 bolt - datum 3 [Flush] (-4.5 mm): Left finger ↔ Left finger pivot 2 M3 bolt
- Left finger pivot 2 lower washer - datum 1 [Flush] (7 mm): Left finger ↔ Left finger pivot 2 lower washer
- Left finger pivot 2 lower washer - datum 2 [Flush] (24 mm): Left finger ↔ Left finger pivot 2 lower washer
- Left finger pivot 2 lower washer - datum 3 [Flush] (-4.5 mm): Left finger ↔ Left finger pivot 2 lower washer
- Left finger pivot 2 upper washer - datum 1 [Flush] (7 mm): Left finger ↔ Left finger pivot 2 upper washer
- Left finger pivot 2 upper washer - datum 2 [Flush] (24 mm): Left finger ↔ Left finger pivot 2 upper washer
- Left finger pivot 2 upper washer - datum 3 [Flush] (6.5 mm): Left finger ↔ Left finger pivot 2 upper washer
- Left finger pivot 2 M3 locking nut - datum 1 [Flush] (7 mm): Left finger ↔ Left finger pivot 2 M3 locking nut
- Left finger pivot 2 M3 locking nut - datum 2 [Flush] (24 mm): Left finger ↔ Left finger pivot 2 M3 locking nut
- Left finger pivot 2 M3 locking nut - datum 3 [Flush] (7 mm): Left finger ↔ Left finger pivot 2 M3 locking nut
- Right gear face height [Flush] (3.5 mm): Lower mounting frame ↔ Right driven gear 26T
- Right gear pivot [Mate]: Lower mounting frame ↔ Right driven gear 26T
- Right follower height [Flush] (8 mm): Lower mounting frame ↔ Right lower follower
- Right follower pivot [Mate]: Lower mounting frame ↔ Right lower follower
- Right finger height [Flush] (12 mm): Lower mounting frame ↔ Right finger
- Right finger upper pivot [Mate]: Right driven gear 26T ↔ Right finger
- Right finger lower pivot [Mate]: Right lower follower ↔ Right finger
- Right finger pivot 1 metal sleeve - datum 1 [Flush]: Right finger ↔ Right finger pivot 1 metal sleeve
- Right finger pivot 1 metal sleeve - datum 2 [Flush]: Right finger ↔ Right finger pivot 1 metal sleeve
- Right finger pivot 1 metal sleeve - datum 3 [Flush] (-4 mm): Right finger ↔ Right finger pivot 1 metal sleeve
- Right finger pivot 1 M3 bolt - datum 1 [Flush]: Right finger ↔ Right finger pivot 1 M3 bolt
- Right finger pivot 1 M3 bolt - datum 2 [Flush]: Right finger ↔ Right finger pivot 1 M3 bolt
- Right finger pivot 1 M3 bolt - datum 3 [Flush] (-4.5 mm): Right finger ↔ Right finger pivot 1 M3 bolt
- Right finger pivot 1 lower washer - datum 1 [Flush]: Right finger ↔ Right finger pivot 1 lower washer
- Right finger pivot 1 lower washer - datum 2 [Flush]: Right finger ↔ Right finger pivot 1 lower washer
- Right finger pivot 1 lower washer - datum 3 [Flush] (-4.5 mm): Right finger ↔ Right finger pivot 1 lower washer
- Right finger pivot 1 upper washer - datum 1 [Flush]: Right finger ↔ Right finger pivot 1 upper washer
- Right finger pivot 1 upper washer - datum 2 [Flush]: Right finger ↔ Right finger pivot 1 upper washer
- Right finger pivot 1 upper washer - datum 3 [Flush] (6.5 mm): Right finger ↔ Right finger pivot 1 upper washer
- Right finger pivot 1 M3 locking nut - datum 1 [Flush]: Right finger ↔ Right finger pivot 1 M3 locking nut
- Right finger pivot 1 M3 locking nut - datum 2 [Flush]: Right finger ↔ Right finger pivot 1 M3 locking nut
- Right finger pivot 1 M3 locking nut - datum 3 [Flush] (7 mm): Right finger ↔ Right finger pivot 1 M3 locking nut
- Right finger pivot 2 metal sleeve - datum 1 [Flush] (-7 mm): Right finger ↔ Right finger pivot 2 metal sleeve
- Right finger pivot 2 metal sleeve - datum 2 [Flush] (24 mm): Right finger ↔ Right finger pivot 2 metal sleeve
- Right finger pivot 2 metal sleeve - datum 3 [Flush] (-4 mm): Right finger ↔ Right finger pivot 2 metal sleeve
- Right finger pivot 2 M3 bolt - datum 1 [Flush] (-7 mm): Right finger ↔ Right finger pivot 2 M3 bolt
- Right finger pivot 2 M3 bolt - datum 2 [Flush] (24 mm): Right finger ↔ Right finger pivot 2 M3 bolt
- Right finger pivot 2 M3 bolt - datum 3 [Flush] (-4.5 mm): Right finger ↔ Right finger pivot 2 M3 bolt
- Right finger pivot 2 lower washer - datum 1 [Flush] (-7 mm): Right finger ↔ Right finger pivot 2 lower washer
- Right finger pivot 2 lower washer - datum 2 [Flush] (24 mm): Right finger ↔ Right finger pivot 2 lower washer
- Right finger pivot 2 lower washer - datum 3 [Flush] (-4.5 mm): Right finger ↔ Right finger pivot 2 lower washer
- Right finger pivot 2 upper washer - datum 1 [Flush] (-7 mm): Right finger ↔ Right finger pivot 2 upper washer
- Right finger pivot 2 upper washer - datum 2 [Flush] (24 mm): Right finger ↔ Right finger pivot 2 upper washer
- Right finger pivot 2 upper washer - datum 3 [Flush] (6.5 mm): Right finger ↔ Right finger pivot 2 upper washer
- Right finger pivot 2 M3 locking nut - datum 1 [Flush] (-7 mm): Right finger ↔ Right finger pivot 2 M3 locking nut
- Right finger pivot 2 M3 locking nut - datum 2 [Flush] (24 mm): Right finger ↔ Right finger pivot 2 M3 locking nut
- Right finger pivot 2 M3 locking nut - datum 3 [Flush] (7 mm): Right finger ↔ Right finger pivot 2 M3 locking nut
- 26T to 26T external gear mesh [RelateRotation] (1 ul): Left driven gear 26T ↔ Right driven gear 26T
- 26T to 18T external gear mesh [RelateRotation] (1.4444 ul): Motor input pinion 18T ↔ Left driven gear 26T
- Jaw opening drive [Angle] (67.2531 deg): Lower mounting frame ↔ Left driven gear 26T
- M3 captive frame nut 1 axis [Mate]: Lower mounting frame ↔ M3 captive frame nut 1
- M3 captive frame nut 1 height [Flush]: Lower mounting frame ↔ M3 captive frame nut 1
- M3 captive frame nut 1 pocket orientation [Angle] (30 deg): Lower mounting frame ↔ M3 captive frame nut 1
- M3 captive frame nut 2 axis [Mate]: Lower mounting frame ↔ M3 captive frame nut 2
- M3 captive frame nut 2 height [Flush]: Lower mounting frame ↔ M3 captive frame nut 2
- M3 captive frame nut 2 pocket orientation [Angle] (30 deg): Lower mounting frame ↔ M3 captive frame nut 2
- M3 captive frame nut 3 axis [Mate]: Lower mounting frame ↔ M3 captive frame nut 3
- M3 captive frame nut 3 height [Flush]: Lower mounting frame ↔ M3 captive frame nut 3
- M3 captive frame nut 3 pocket orientation [Angle] (30 deg): Lower mounting frame ↔ M3 captive frame nut 3
- Rotating motor output shaft - datum 1 [Flush]: Motor input pinion 18T ↔ Rotating motor output shaft
- Rotating motor output shaft - datum 2 [Flush]: Motor input pinion 18T ↔ Rotating motor output shaft
- Rotating motor output shaft - datum 3 [Flush]: Motor input pinion 18T ↔ Rotating motor output shaft
- M3 motor shaft set screw - datum 1 [Flush]: Motor input pinion 18T ↔ M3 motor shaft set screw
- M3 motor shaft set screw - datum 2 [Flush] (2 mm): Motor input pinion 18T ↔ M3 motor shaft set screw
- M3 motor shaft set screw - datum 3 [Flush] (-5 mm): Motor input pinion 18T ↔ M3 motor shaft set screw
- Left foam contact pad - datum 1 [Flush]: Left finger ↔ Left foam contact pad
- Left foam contact pad - datum 2 [Flush]: Left finger ↔ Left foam contact pad
- Left foam contact pad - datum 3 [Flush]: Left finger ↔ Left foam contact pad
- Right foam contact pad - datum 1 [Flush]: Right finger ↔ Right foam contact pad
- Right foam contact pad - datum 2 [Flush]: Right finger ↔ Right foam contact pad
- Right foam contact pad - datum 3 [Flush]: Right finger ↔ Right foam contact pad
## Named parameters: JawOpening = 75 mm, LinkLength = 45 mm, ObjectWidth = 70 mm
